# Autodesk Inventor assembly: SensorBox-panel-fit
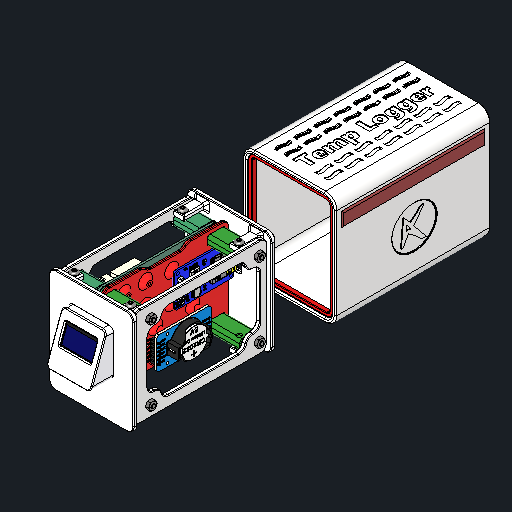
[picture p0: Inventor's stored thumbnail of the model, 512x512]
Saved by Autodesk Inventor 2027.1 (Build 311270010, 270A)
## iProperties
Created: 2026-10-26
Part Number: SensorBox-panel-fit
Description: Mechanical panel fit fixture; grounded inspection layout, not a finished instrument
Document SubType Name: Assembly
Designer: queezz
Author: queezz
## Documents named in this file (20)
- C:\Users\queezz\Dropbox\Drawings\pihti-cad\ElectronicsBox\modular-sensor-box\SensorBox-panel-fit.iam
- C:\Users\queezz\Dropbox\Drawings\pihti-cad\ContentCenter\Fastners\M3-nut.ipt
- C:\Users\queezz\Dropbox\Drawings\pihti-cad\ElectronicsBox\esp32-ambient-logger\temp-logger-shelf-v2.ipt
- C:\Users\queezz\Dropbox\Drawings\pihti-cad\ElectronicsBox\esp32-ambient-logger\shaft-10mm.ipt
- C:\Users\queezz\Dropbox\Drawings\pihti-cad\ElectronicsBox\esp32-ambient-logger\temp-logger-base-plate-v2.ipt
- C:\Users\queezz\Dropbox\Drawings\pihti-cad\ElectronicsBox\esp32-ambient-logger\m3-60-pin.ipt
- C:\Users\queezz\Dropbox\Drawings\pihti-cad\ElectronicsBox\esp32-ambient-logger\enclosure.ipt
- C:\Users\queezz\Dropbox\Drawings\pihti-cad\ElectronicsBox\modular-sensor-box\sensor-box-front-panel.ipt
- C:\Users\queezz\Dropbox\Drawings\pihti-cad\ElectronicsBox\modular-sensor-box\sensor-box-back-panel.ipt
- C:\Users\queezz\Dropbox\Drawings\pihti-cad\ElectronicsBox\modular-sensor-box\sensor-box-upper-mount-spacer.ipt
- C:\Users\queezz\Dropbox\Drawings\pihti-cad\ElectronicsBox\modular-sensor-box\sensor-box-lower-mount-spacer.ipt
- C:\Users\queezz\Dropbox\Drawings\pihti-cad\ContentCenter\Fastners\M3x8-BHCS.ipt
- C:\Users\queezz\Dropbox\Drawings\pihti-cad\ElectronicsBox\esp32-ambient-logger\TempLoggerRev1.iam
- C:\Users\queezz\Dropbox\Drawings\pihti-cad\ElectronicsBox\esp32-ambient-logger\STEPs\ESP32-DevkitC32U.iam
- C:\Users\queezz\Dropbox\Drawings\pihti-cad\ElectronicsBox\esp32-ambient-logger\STEPs\DS3231 RTC\DS2321 RTC.ipt
- C:\Users\queezz\Dropbox\Drawings\pihti-cad\ElectronicsBox\esp32-ambient-logger\STEPs\Product_TF Micro SD Card Memory Modul .iam
- C:\Users\queezz\Dropbox\Drawings\pihti-cad\ElectronicsBox\esp32-ambient-logger\STEPs\OLED-128x64-0.96.ipt
- C:\Users\queezz\Dropbox\Drawings\pihti-cad\ContentCenter\Fastners\M2x4-SHCS.ipt
- C:\Users\queezz\Dropbox\Drawings\pihti-cad\ElectronicsBox\esp32-ambient-logger\oled-screen-mount.ipt
- C:\Users\queezz\Dropbox\Drawings\pihti-cad\ElectronicsBox\modular-sensor-box\sensor-box-oled-sleeve-trial.ipt
## Components (49 placed, 32 different names)
1. JIS B 1181 Style 1 - Metric A M3:1
2. JIS B 1181 Style 1 - Metric A M3:2
3. JIS B 1181 Style 1 - Metric A M3:3
4. JIS B 1181 Style 1 - Metric A M3:4
5. JIS B 1181 Style 1 - Metric A M3:6
6. JIS B 1181 Style 1 - Metric A M3:7
7. JIS B 1181 Style 1 - Metric A M3:8
8. temp-logger-shelf-v2:1
9. shaft-10mm:1
10. shaft-10mm:2
11. shaft-10mm:3
12. shaft-10mm:4
13. temp-logger-base-plate-v2:1
14. temp-logger-base-plate-v2:2
15. m3-60-pin:2
16. m3-60-pin:3
17. m3-60-pin:4
18. enclosure:1
19. sensor-box-front-panel — Mate:1
20. sensor-box-back-panel
21. upper mount -26.5 -38.5
22. upper mount -26.5 38.5
23. upper mount 26.5 -38.5
24. upper mount 26.5 38.5
25. lower mount -26.5 -38.5
26. lower mount -26.5 38.5
27. lower mount 26.5 -38.5
28. lower mount 26.5 38.5
29. Panel screw -1 -32 -20
30. Panel screw -1 -32 20
31. Panel screw -1 45 -20
32. Panel screw -1 45 20
33. Panel screw 1 -32 -20
34. Panel screw 1 -32 20
35. Panel screw 1 45 -20
36. Panel screw 1 45 20
37. m3-60-pin:1
38. JIS B 1181 Style 1 - Metric A M3:5
39. TempLoggerRev1:1 [sub-assembly]
40. ESP32-DevkitC32U:1 [sub-assembly]
41. DS2321 RTC:1
42. Product_TF Micro SD Card Memory Modul :1 [sub-assembly]
43. OLED-128x64-0.96:1
44. SS ISO 4762 M2 x 4:1
45. SS ISO 4762 M2 x 4:2
46. SS ISO 4762 M2 x 4:3
47. SS ISO 4762 M2 x 4:4
48. oled-screen-mount:1 — Mate:2, Mate:3
49. OLED sleeve trial — Mate:1, Mate:2, Mate:3
## Relationships (3: Mate 3)
- Mate:1: sensor-box-front-panel ↔ OLED sleeve trial
- Mate:2: oled-screen-mount:1 ↔ OLED sleeve trial
- Mate:3: oled-screen-mount:1 ↔ OLED sleeve trial
